# Autodesk Inventor assembly: Membrane-flange
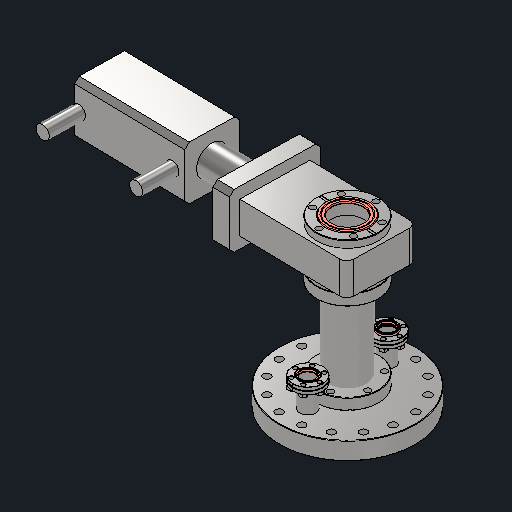
[picture p0: Inventor's stored thumbnail of the model, 512x512]
Saved by Autodesk Inventor 2027.1 (Build 311270010, 270A)
## iProperties
Created: 2019-10-17
Part Number: Membrane-flange
Document SubType Name: Assembly
Designer: kuzmin
Mass: 4363.93 g
Surface Area: 2140.49 cm^2
Volume: 545.917 cm^3
Density: 7.99376 g/cm^3
Author: kuzmin
## iProperties of the stored document MemberDocs/xAaaaqkbaAaaaaaaaAaaaanrgXc
Created: 2019-10-17
Part Number: Membrane-flange
Document SubType Name: Assembly
Designer: kuzmin
Mass: 4363.93 g
Surface Area: 2140.49 cm^2
Volume: 545.917 cm^3
Density: 7.99376 g/cm^3
Author: kuzmin
## Documents named in this file (24)
- C:\Users\queezz\Dropbox\Drawings\pihti-cad\Miura-membrane-experiments\MembraneFlangeWithGV.iam
- C:\Users\queezz\Dropbox\Drawings\pihti-cad\Miura-membrane-experiments\152-double-70.ipt
- C:\Users\queezz\Dropbox\Drawings\pihti-cad\Miura-membrane-experiments\components\Gasket_70.ipt
- C:\Users\queezz\Dropbox\Drawings\pihti-cad\Miura-membrane-experiments\components\Gasket_152.ipt
- C:\Users\queezz\Dropbox\Drawings\pihti-cad\Miura-membrane-experiments\components\Gasket_34.ipt
- C:\Users\queezz\Dropbox\Drawings\pihti-cad\Miura-membrane-experiments\34-port1.ipt
- C:\Users\queezz\Dropbox\Drawings\pihti-cad\Miura-membrane-experiments\components\AS 1112 - M4  Type 5.ipt
- C:\Users\queezz\Dropbox\Drawings\pihti-cad\Miura-membrane-experiments\components\ICF70to34.ipt
- C:\Users\queezz\Dropbox\Drawings\pihti-cad\Miura-membrane-experiments\CF70_nipple_Membrane.iam
- C:\Users\queezz\Dropbox\Drawings\pihti-cad\Miura-membrane-experiments\Miura-Gatevalve_70_pneumatic.iam
- C:\Users\mkse\Dropbox\研究室\Leprecon\Membrane_Flange\Membrane-welded.iam
- C:\Users\mkse\Dropbox\研究室\Leprecon\Membrane_Flange\152-double-70.ipt
- C:\Users\mkse\Dropbox\研究室\Leprecon\ICFs\Gasket_70.ipt
- C:\Users\mkse\Dropbox\研究室\Leprecon\ICFs\ICF-70-nipple-VUV.iam
- C:\Users\mkse\Dropbox\研究室\Leprecon\StandarComponents\ISO 4017 - M6 x 25 - ISO.ipt
- C:\Users\mkse\Dropbox\研究室\Leprecon\ICFs\Gasket_152.ipt
- C:\Users\mkse\Dropbox\研究室\Leprecon\ICFs\Gasket_34.ipt
- C:\Users\mkse\Dropbox\研究室\Leprecon\Downloaded\cosmotec-feed\C15K110A1CUM5N.iam
- C:\Users\mkse\Dropbox\研究室\Leprecon\Downloaded\cosmo-34L\ICF34EL.iam
- C:\Users\mkse\Dropbox\研究室\Leprecon\StandarComponents\BS 3692 - M4 x 18(1).ipt
- C:\Users\mkse\Dropbox\研究室\Leprecon\Membrane_Flange\34-port1.ipt
- C:\Users\mkse\Dropbox\研究室\Leprecon\StandarComponents\AS 1112 - M4  Type 5.ipt
- C:\Users\mkse\Dropbox\研究室\Leprecon\ICFs\ICF70to34.ipt
- C:\Users\shora\Dropbox\Leprecon\Membrane_Flange\Membrane-flange-V2.iam
## Components (25 placed, 9 different names)
1. 152-double-70:1 — Rotational:1, Flush:1, Mate:11, Mate:12, Rotational:5, Rotational:8, Rigid:5, Rotational:27, Mate:13, Mate:14
2. Gasket_70:1 — Rotational:1, 挿入:17
3. Gasket_70:2 — Rotational:5
4. Gasket_152:1 — Rotational:8
5. Gasket_34:1 — Rotational:15
6. Gasket_34:2
7. 34-port1:1 — Insert:16, Rotational:16, Rotational:17, Rotational:18, Rotational:19, Rotational:20, Rotational:27
8. 34-port1:2 — Rigid:5, Rotational:15, Rotational:21, Rotational:22, Rotational:23, Rotational:24, Rotational:25, Rotational:26
9. ICF70to34:1 — 挿入:17
10. CF70_nipple_Membrane:1 [sub-assembly] — Mate:13, Mate:14, Mate:15, Mate:16, Mate:18
11. Miura-Gatevalve_70_pneumatic:1 [sub-assembly] — Mate:17, Mate:18, Mate:19, Mate:20
12. Gasket_70:3 — Mate:15, Mate:16, Mate:17
13. Gasket_70:4 — Mate:19, Mate:20
14. AS 1112 (2) - Metric M4  Type 5:1 — Insert:16
15. AS 1112 (2) - Metric M4  Type 5:2 — Rotational:17
16. AS 1112 (2) - Metric M4  Type 5:3 — Rotational:16
17. AS 1112 (2) - Metric M4  Type 5:4 — Rotational:19
18. AS 1112 (2) - Metric M4  Type 5:5 — Rotational:20
19. AS 1112 (2) - Metric M4  Type 5:6 — Rotational:18
20. AS 1112 (2) - Metric M4  Type 5:7 — Rotational:26
21. AS 1112 (2) - Metric M4  Type 5:8 — Rotational:23
22. AS 1112 (2) - Metric M4  Type 5:9 — Rotational:24
23. AS 1112 (2) - Metric M4  Type 5:10 — Rotational:22
24. AS 1112 (2) - Metric M4  Type 5:11 — Rotational:21
25. AS 1112 (2) - Metric M4  Type 5:12 — Rotational:25
## Relationships (30: RevoluteJoint 16, Mate 10, Insert 2, Flush 1, WeldJoint 1)
- Rotational:1 [RevoluteJoint]: 152-double-70:1 ↔ Gasket_70:1
- Flush:1: 152-double-70:1
- Mate:11: 152-double-70:1
- Mate:12: 152-double-70:1
- Rotational:5 [RevoluteJoint]: 152-double-70:1 ↔ Gasket_70:2
- Rotational:8 [RevoluteJoint]: 152-double-70:1 ↔ Gasket_152:1
- Rigid:5 [WeldJoint]: 152-double-70:1 ↔ 34-port1:2
- Rotational:15 [RevoluteJoint]: Gasket_34:1 ↔ 34-port1:2
- Insert:16: 34-port1:1 ↔ AS 1112 (2) - Metric M4  Type 5:1
- Rotational:16 [RevoluteJoint]: 34-port1:1 ↔ AS 1112 (2) - Metric M4  Type 5:3
- Rotational:17 [RevoluteJoint]: 34-port1:1 ↔ AS 1112 (2) - Metric M4  Type 5:2
- Rotational:18 [RevoluteJoint]: 34-port1:1 ↔ AS 1112 (2) - Metric M4  Type 5:6
- Rotational:19 [RevoluteJoint]: 34-port1:1 ↔ AS 1112 (2) - Metric M4  Type 5:4
- Rotational:20 [RevoluteJoint]: 34-port1:1 ↔ AS 1112 (2) - Metric M4  Type 5:5
- Rotational:21 [RevoluteJoint]: 34-port1:2 ↔ AS 1112 (2) - Metric M4  Type 5:11
- Rotational:22 [RevoluteJoint]: 34-port1:2 ↔ AS 1112 (2) - Metric M4  Type 5:10
- Rotational:23 [RevoluteJoint]: 34-port1:2 ↔ AS 1112 (2) - Metric M4  Type 5:8
- Rotational:24 [RevoluteJoint]: 34-port1:2 ↔ AS 1112 (2) - Metric M4  Type 5:9
- Rotational:25 [RevoluteJoint]: 34-port1:2 ↔ AS 1112 (2) - Metric M4  Type 5:12
- Rotational:26 [RevoluteJoint]: 34-port1:2 ↔ AS 1112 (2) - Metric M4  Type 5:7
- Rotational:27 [RevoluteJoint]: 152-double-70:1 ↔ 34-port1:1
- 挿入:17 [Insert]: Gasket_70:1 ↔ ICF70to34:1
- Mate:13: 152-double-70:1 ↔ CF70_nipple_Membrane:1
- Mate:14: 152-double-70:1 ↔ CF70_nipple_Membrane:1
- Mate:15: CF70_nipple_Membrane:1 ↔ Gasket_70:3
- Mate:16: CF70_nipple_Membrane:1 ↔ Gasket_70:3
- Mate:17: Miura-Gatevalve_70_pneumatic:1 ↔ Gasket_70:3
- Mate:18: CF70_nipple_Membrane:1 ↔ Miura-Gatevalve_70_pneumatic:1
- Mate:19: Miura-Gatevalve_70_pneumatic:1 ↔ Gasket_70:4
- Mate:20: Miura-Gatevalve_70_pneumatic:1 ↔ Gasket_70:4
